# Autodesk Inventor assembly: motor_stationary_part
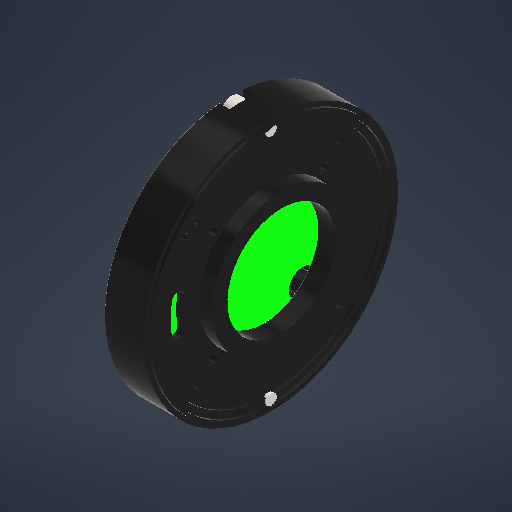
[picture p0: Inventor's stored thumbnail of the model, 512x512]
Saved by Autodesk Inventor 2027.1 (Build 311270010, 270A)
## iProperties
Created: 2026-10-15
Part Number: motor_stationary_part
Document SubType Name: Assembly
Designer: lucao
Author: lucao
## Documents named in this file (5)
- C:\Users\lucao\Desktop\RL-Rotary-Inverted-Double-Pendulum\CAD\motor_stationary_part.iam
- C:\Users\lucao\Desktop\RL-Rotary-Inverted-Double-Pendulum\CAD\motor\L-7015-251029\2D3D\RMD-7015三维图\RMD-7015\Volumenkörper6.ipt
- C:\Users\lucao\Desktop\RL-Rotary-Inverted-Double-Pendulum\CAD\motor\L-7015-251029\2D3D\RMD-7015三维图\RMD-7015\Volumenkörper4.ipt
- C:\Users\lucao\Desktop\RL-Rotary-Inverted-Double-Pendulum\CAD\motor\L-7015-251029\2D3D\RMD-7015三维图\RMD-7015\Volumenkörper2.ipt
- C:\Users\lucao\Desktop\RL-Rotary-Inverted-Double-Pendulum\CAD\motor\L-7015-251029\2D3D\RMD-7015三维图\RMD-7015\Volumenkörper3.ipt
## Components (4 placed, 4 different names)
1. Volumenkörper6:1
2. Volumenkörper4:1
3. Volumenkörper2:1
4. Volumenkörper3:1
## Relationships (3: Symmetry 1, Mate 1, Angle 1)
- Symmetry:1
- Mate:1
- Angle:1 (90 deg)
